# Autodesk Inventor assembly: 4444 FP-496x1546x47
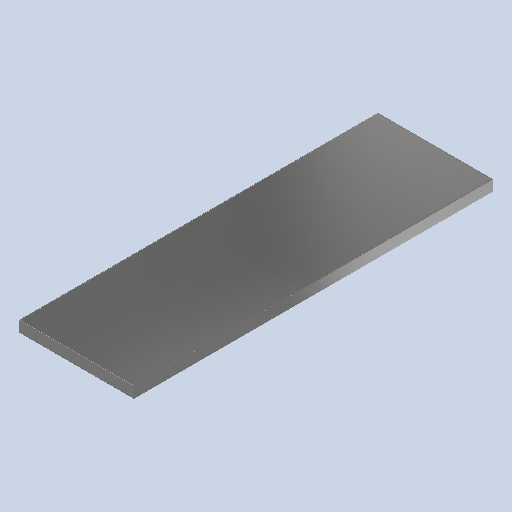
[picture p0: Inventor's stored thumbnail of the model, 512x512]
Saved by Autodesk Inventor 2024.4 (Build 284460030, 460C)
## iProperties
RuleStatus: InUse
Created: 2019-06-24
Part Number: 4444 FP-496x1546x47
Material: Generisch
Document SubType Name: Assembly
Designer: MK
Mass: 7678.01 g
Surface Area: 19632 cm^2
Volume: 978.09 cm^3
Density: 7.85 g/cm^3
Description: Tür-Paneel
InventorSizerSetup: FP 1T 1
Author: MK
## Documents named in this file (3)
- C:\Users\ahmad\OneDrive\Desktop\Inventor_Sizer\C# Version\GR\Einzelteile\4444 FP-496x1546x47.iam
- C:\Users\ahmad\OneDrive\Desktop\Inventor_Sizer\C# Version\GR\Einzelteile\4444 496x1546x47-Au.ipt
- C:\Users\ahmad\OneDrive\Desktop\Inventor_Sizer\C# Version\GR\Einzelteile\4444 496x1546x47-In.ipt
## Components (2 placed, 2 different names)
1. 4444 496x1546x47-Au:1 — Mate:6, Mate:7, Mate:8
2. 4444 496x1546x47-In:1 — Mate:6, Mate:7, Mate:8
## Relationships (3: Mate 3)
- Mate:6: 4444 496x1546x47-Au:1 ↔ 4444 496x1546x47-In:1
- Mate:7 (0.5 mm): 4444 496x1546x47-Au:1 ↔ 4444 496x1546x47-In:1
- Mate:8 (0.5 mm): 4444 496x1546x47-Au:1 ↔ 4444 496x1546x47-In:1
## Named parameters: Clearance = 0.5 mm, HingeCount = 2, HingePitch = 537 mm, HandleCount = 2, HandlePitch = 298 mm, Width = 496 mm
